# Autodesk Inventor assembly: 4861 FP-696x1546x47
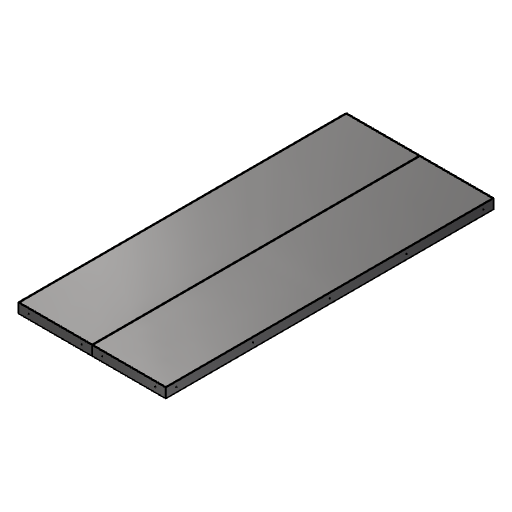
[picture p0: Inventor's stored thumbnail of the model, 512x512]
Saved by Autodesk Inventor 2024.3 (Build 283343000, 343)
## iProperties
RuleStatus: InUse
Created: 2019-06-24
Part Number: 4861 FP-696x1546x47
Material: Generisch
Document SubType Name: Assembly
Designer: MK
Mass: 21050.8 g
Surface Area: 53770.1 cm^2
Volume: 2681.63 cm^3
Density: 7.85 g/cm^3
Description: Tür-Paneel
InventorSizerSetup: FP 2
Author: MK
## Documents named in this file (3)
- C:\Users\la\Documents\GitHub\Inventor_Sizer\C# Version\GR\Einzelteile\4861 FP-696x1546x47.iam
- C:\Users\la\Documents\GitHub\Inventor_Sizer\C# Version\GR\Einzelteile\4861 696x1546x47-Au.ipt
- C:\Users\la\Documents\GitHub\Inventor_Sizer\C# Version\GR\Einzelteile\4861 696x1546x47-In-2T.ipt
## Components (3 placed, 2 different names)
1. 4861 696x1546x47-Au:1 — Mate:6, Mate:7, Mate:8
2. 4861 696x1546x47-In-2T:1 — Mate:6, Mate:7, Mate:8
3. 4861 696x1546x47-In-2T:2
## Component patterns: (2 elements, first: 4861 696x1546x47-In-2T:1)
## Relationships (3: Mate 3)
- Mate:6: 4861 696x1546x47-Au:1 ↔ 4861 696x1546x47-In-2T:1
- Mate:7 (0.5 mm): 4861 696x1546x47-Au:1 ↔ 4861 696x1546x47-In-2T:1
- Mate:8 (0.5 mm): 4861 696x1546x47-Au:1 ↔ 4861 696x1546x47-In-2T:1
## Named parameters: Clearance = 0.5 mm, Width = 696 mm, InSplit = 2, InWidth = 346.5 mm
